# Autodesk Inventor assembly: ArmAssemblyL
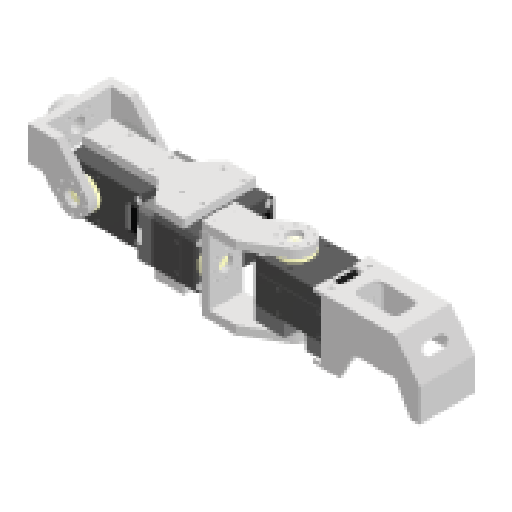
[picture p0: Inventor's stored thumbnail of the model, 512x512]
Saved by Autodesk Inventor 2025.2 (Build 292293000, 293)
## iProperties
Created: 2025-06-27
Part Number: ArmAssemblyL
Document SubType Name: Assembly
Designer: ricoa
Author: ricoa
## Documents named in this file (9)
- C:\Users\ricoa\Desktop\PROYEK AKHIR\project_pororo\Arm\ArmAssemblyL.iam
- C:\Users\ricoa\Desktop\PROYEK AKHIR\project_pororo\Arm\ConnectorBodytoArm.ipt
- C:\Users\ricoa\Desktop\PROYEK AKHIR\project_pororo\XM430-W350-R\XM430-W350-R\XM430-W350-R.iam
- C:\Users\ricoa\Desktop\PROYEK AKHIR\project_pororo\Arm\ShoulderSideL.ipt
- C:\Users\ricoa\Desktop\PROYEK AKHIR\project_pororo\Arm\ShoulderFrontL.ipt
- C:\Users\ricoa\Desktop\PROYEK AKHIR\project_pororo\Arm\ConnectortoElbowSide.ipt
- C:\Users\ricoa\Desktop\PROYEK AKHIR\project_pororo\Arm\ElbowSide.ipt
- C:\Users\ricoa\Desktop\PROYEK AKHIR\project_pororo\Arm\ElbowTop.ipt
- C:\Users\ricoa\Desktop\PROYEK AKHIR\project_pororo\Arm\Fist.ipt
## Components (13 placed, 8 different names)
1. ConnectorBodytoArm:1 — Mate:4, Mate:7, Mate:27
2. XM430-W350-R:1 [sub-assembly] — Flush:3, Mate:9, Mate:10, Mate:11, Mate:12, Mate:13, Flush:5, Mate:14, Mate:37, Mate:39, Mate:40
3. ShoulderSideL:1 — Flush:2, Mate:5, Mate:6, Mate:37, Mate:39, Mate:40
4. ShoulderSideL:2 — Mate:8, Mate:28
5. ShoulderFrontL:1 — Flush:2, Mate:4, Mate:5, Mate:6, Mate:7, Mate:8, Mate:27, Mate:28
6. XM430-W350-R:2 [sub-assembly] — Flush:5, Mate:14, Mate:15, Flush:7, Mate:19, Mate:25
7. ConnectortoElbowSide:1 — Flush:3, Mate:9, Mate:10, Mate:15
8. ConnectortoElbowSide:2 — Mate:11, Mate:12, Mate:13
9. XM430-W350-R:3 [sub-assembly] — Flush:9, Mate:22, Mate:23, Mate:43, Mate:44, Mate:45
10. ElbowSide:1 — Mate:46, Mate:47
11. ElbowSide:2 — Mate:41, Mate:42, Mate:43, Mate:44, Mate:45
12. ElbowTop:1 — Flush:7, Mate:19, Mate:25, Mate:41, Mate:42, Mate:46, Mate:47
13. Fist:1 — Flush:9, Mate:22, Mate:23
## Relationships (33: Mate 28, Flush 5)
- Flush:2: ShoulderSideL:1 ↔ ShoulderFrontL:1
- Mate:4: ConnectorBodytoArm:1 ↔ ShoulderFrontL:1
- Mate:5: ShoulderSideL:1 ↔ ShoulderFrontL:1
- Mate:6: ShoulderSideL:1 ↔ ShoulderFrontL:1
- Mate:7: ConnectorBodytoArm:1 ↔ ShoulderFrontL:1
- Mate:8: ShoulderSideL:2 ↔ ShoulderFrontL:1
- Flush:3: XM430-W350-R:1 ↔ ConnectortoElbowSide:1
- Mate:9: XM430-W350-R:1 ↔ ConnectortoElbowSide:1
- Mate:10: XM430-W350-R:1 ↔ ConnectortoElbowSide:1
- Mate:11: XM430-W350-R:1 ↔ ConnectortoElbowSide:2
- Mate:12: XM430-W350-R:1 ↔ ConnectortoElbowSide:2
- Mate:13: XM430-W350-R:1 ↔ ConnectortoElbowSide:2
- Flush:5 (-6.25 mm): XM430-W350-R:1 ↔ XM430-W350-R:2
- Mate:14 (2.25 mm): XM430-W350-R:1 ↔ XM430-W350-R:2
- Mate:15: XM430-W350-R:2 ↔ ConnectortoElbowSide:1
- Flush:7: XM430-W350-R:2 ↔ ElbowTop:1
- Mate:19: XM430-W350-R:2 ↔ ElbowTop:1
- Flush:9: XM430-W350-R:3 ↔ Fist:1
- Mate:22: XM430-W350-R:3 ↔ Fist:1
- Mate:23: XM430-W350-R:3 ↔ Fist:1
- Mate:25: XM430-W350-R:2 ↔ ElbowTop:1
- Mate:27: ConnectorBodytoArm:1 ↔ ShoulderFrontL:1
- Mate:28: ShoulderSideL:2 ↔ ShoulderFrontL:1
- Mate:37: XM430-W350-R:1 ↔ ShoulderSideL:1
- Mate:39: XM430-W350-R:1 ↔ ShoulderSideL:1
- Mate:40: XM430-W350-R:1 ↔ ShoulderSideL:1
- Mate:41: ElbowSide:2 ↔ ElbowTop:1
- Mate:42: ElbowSide:2 ↔ ElbowTop:1
- Mate:43: XM430-W350-R:3 ↔ ElbowSide:2
- Mate:44: XM430-W350-R:3 ↔ ElbowSide:2
- Mate:45: XM430-W350-R:3 ↔ ElbowSide:2
- Mate:46: ElbowSide:1 ↔ ElbowTop:1
- Mate:47: ElbowSide:1 ↔ ElbowTop:1
